# Autodesk Inventor assembly: подъемная часть
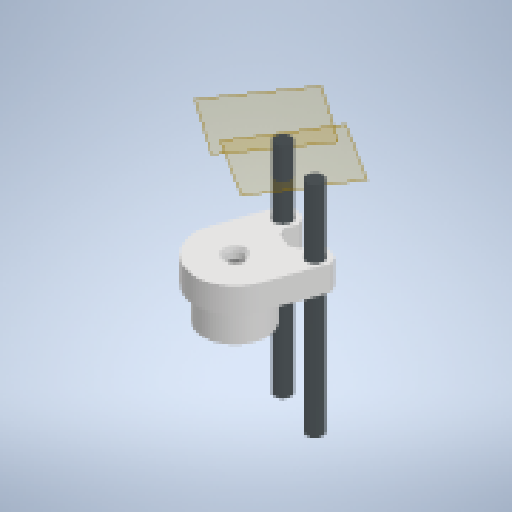
[picture p0: Inventor's stored thumbnail of the model, 512x512]
Saved by Autodesk Inventor 2024.2 (Build 282272000, 272)
## iProperties
Created: 2026-10-27
Part Number: подъемная часть
Document SubType Name: Assembly
Designer: katya_notebook
Author: katya_notebook
## Documents named in this file (4)
- D:\alletz2\ETZ_10\construction\робот\подъемная часть.iam
- D:\alletz2\ETZ_10\construction\робот\электромагнит.ipt
- D:\alletz2\ETZ_10\construction\робот\крепление магнита.ipt
- D:\alletz2\ETZ_10\construction\робот\вал.ipt
## Components (4 placed, 3 different names)
1. электромагнит:1 — Заподлицо:1, С поворотом:1
2. крепление магнита:1 — Заподлицо:1, Цилиндрический:1, Цилиндрический:2, С поворотом:1
3. вал:1 — Цилиндрический:1, Заподлицо:2
4. вал:2 — Цилиндрический:2, Заподлицо:2
## Relationships (5: Flush 2, CylindricalJoint 2, RevoluteJoint 1)
- Заподлицо:1 [Flush]: электромагнит:1 ↔ крепление магнита:1
- Цилиндрический:1 [CylindricalJoint]: крепление магнита:1 ↔ вал:1
- Цилиндрический:2 [CylindricalJoint]: крепление магнита:1 ↔ вал:2
- С поворотом:1 [RevoluteJoint]: электромагнит:1 ↔ крепление магнита:1
- Заподлицо:2 [Flush]: вал:1 ↔ вал:2
